# Autodesk Inventor assembly: 3.25 Traction AS, No Insert_MIR
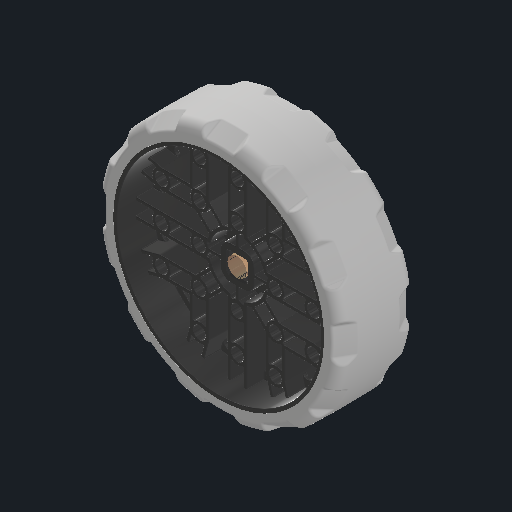
[picture p0: Inventor's stored thumbnail of the model, 512x512]
Saved by Autodesk Inventor 2026.2 (Build 302298000, 298)
## iProperties
Created: 2022-08-02
Part Number: 3.25 Traction AS, No Insert_MIR
Document SubType Name: Assembly
Designer: BuddyProject
Author: ylu12
## Documents named in this file (2)
- E:\593C-CAD-26-27\Mirrored Parts\3.25 Traction AS, No Insert_MIR.iam
- E:\593C-CAD-26-27\Mirrored Parts\3.25 Traction Antistatic_MIR.ipt
## Components (1 placed, 1 different names)
1. 3.25 Traction Antistatic_MIR:1 — Mate:24, Mate:22, Mate:20
## Relationships (3: Flush 2, Mate 1)
- Mate:24 [Flush]: 3.25 Traction Antistatic_MIR:1
- Mate:22 [Flush]: 3.25 Traction Antistatic_MIR:1
- Mate:20: 3.25 Traction Antistatic_MIR:1
## Named parameters: Thickness = 8.255 mm
